# Autodesk Inventor assembly: DM-J4310
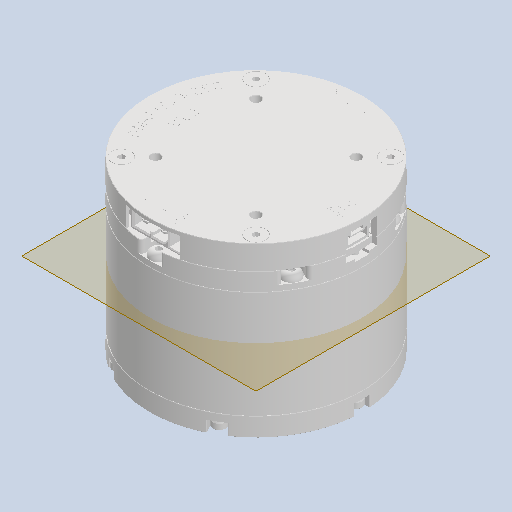
[picture p0: Inventor's stored thumbnail of the model, 512x512]
Saved by Autodesk Inventor 2025.3 (Build 293356000, 356)
## iProperties
Created: 2026-03-02
Part Number: DM-J4310
Document SubType Name: Assembly
Designer: Admin
Sending System: CREO PARAMETRIC BY PTC INC, 2020053
Preprocessor: CREO PARAMETRIC BY PTC INC, 2020053
Title: 4310__3D_20240814_1
Author: rw
Revision Number: 2LAST_VERSION
## Documents named in this file (15)
- C:\Users\shfzf\Desktop\FEIBOT\ROBOT_CAD\DM-J4310\DM-J4310.iam
- C:\Users\shfzf\Desktop\FEIBOT\ROBOT_CAD\DM-J4310\4310__3D_20240814_1_2_1.ipt
- C:\Users\shfzf\Desktop\FEIBOT\ROBOT_CAD\DM-J4310\4340__3D_20240814_1_2_4.ipt
- C:\Users\shfzf\Desktop\FEIBOT\ROBOT_CAD\DM-J4310\4310_202409130001.ipt
- C:\Users\shfzf\Desktop\FEIBOT\ROBOT_CAD\DM-J4310\4310__3D_20240814_1_2_3.ipt
- C:\Users\shfzf\Desktop\FEIBOT\ROBOT_CAD\DM-J4310\4310__3D_20240814_1_2_2.ipt
- C:\Users\shfzf\Desktop\FEIBOT\ROBOT_CAD\DM-J4310\4310__3D_20240814_1_2_5.ipt
- C:\Users\shfzf\Desktop\FEIBOT\ROBOT_CAD\DM-J4310\4310__3D_20240814_1_2_6.ipt
- C:\Users\shfzf\Desktop\FEIBOT\ROBOT_CAD\DM-J4310\4310__3D_20240814_1_2_7.ipt
- C:\Users\shfzf\Desktop\FEIBOT\ROBOT_CAD\DM-J4310\4310__3D_20240814_1_2_8.ipt
- C:\Users\shfzf\Desktop\FEIBOT\ROBOT_CAD\DM-J4310\4310__3D_20240814_1_2_9.ipt
- C:\Users\shfzf\Desktop\FEIBOT\ROBOT_CAD\DM-J4310\4310__3D_20240814_1_2_10.ipt
- C:\Users\shfzf\Desktop\FEIBOT\ROBOT_CAD\DM-J4310\M2_5-L6.ipt
- C:\Users\shfzf\Desktop\FEIBOT\ROBOT_CAD\DM-J4310\_M2_5-100001.ipt
- C:\Users\shfzf\Desktop\FEIBOT\ROBOT_CAD\DM-J4310\M2_5-L4.ipt
## Components (26 placed, 26 different names)
1. 4310__3D_20240814_1_2_1_216
2. 4340__3D_20240814_1_2_4_217
3. 4310_202409130001_218
4. 4310__3D_20240814_1_2_3_219
5. 4310__3D_20240814_1_2_2_220 — 表面齐平:1
6. 4310__3D_20240814_1_2_5_221
7. 4310__3D_20240814_1_2_6_222
8. 4310__3D_20240814_1_2_7_223
9. 4310__3D_20240814_1_2_8_224
10. 4310__3D_20240814_1_2_9_225
11. 4310__3D_20240814_1_2_10_226
12. M2_5-L6_227
13. M2_5-L6_228
14. M2_5-L6_229
15. M2_5-L6_230
16. M2_5-L6_231
17. M2_5-L6_232
18. M2_5-L6_233
19. _M2_5-100001_234
20. _M2_5-100001_235
21. _M2_5-100001_236
22. _M2_5-100001_237
23. M2_5-L4_238
24. M2_5-L4_239
25. M2_5-L4_240
26. M2_5-L4_241
## Relationships (1: Flush 1)
- 表面齐平:1 [Flush] (-23 mm): 4310__3D_20240814_1_2_2_220
